# Autodesk Inventor assembly: Montagem1
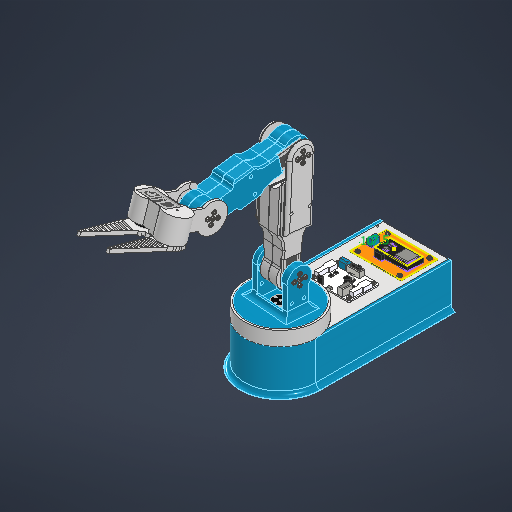
[picture p0: Inventor's stored thumbnail of the model, 512x512]
Saved by Autodesk Inventor 2027.1 (Build 311270010, 270A)
## iProperties
Created: 2026-11-04
Part Number: Montagem1
Document SubType Name: Assembly
Designer: Evellyn
Author: Evellyn
## Documents named in this file (21)
- C:\Users\Evellyn\Desktop\New-Robotic-Arm\mecanica\partes_ipt\Montagem1.iam
- C:\Users\Evellyn\Desktop\New-Robotic-Arm\mecanica\partes_ipt\modificacao_manipulador_base.ipt
- C:\Users\Evellyn\Desktop\New-Robotic-Arm\mecanica\partes_ipt\fonte.ipt
- C:\Users\Evellyn\Desktop\New-Robotic-Arm\mecanica\partes_ipt\modificacao_tampa_base.ipt
- C:\Users\Evellyn\Desktop\New-Robotic-Arm\mecanica\partes_ipt\PCB.ipt
- C:\Users\Evellyn\Desktop\New-Robotic-Arm\mecanica\partes_ipt\SERIAL_BUS_SERVO_CONTROLLER.ipt
- C:\Users\Evellyn\Desktop\New-Robotic-Arm\mecanica\partes_ipt\STEP_DOWN_LM2596.ipt
- C:\Users\Evellyn\Documents\Inventor\Content Center Files\R2027\pt-BR\NF EN ISO 7045 - Z\EN ISO 7045 - M3 x 5 - 4.8 - Z(2).ipt
- C:\Users\Evellyn\Documents\Inventor\Content Center Files\R2027\pt-BR\NF EN ISO 7045 - Z\EN ISO 7045 - M3 x 4 - 4.8 - Z(2).ipt
- C:\Users\Evellyn\Desktop\New-Robotic-Arm\mecanica\partes_ipt\servo LX-15D 2.ipt
- C:\Users\Evellyn\Documents\Inventor\Content Center Files\R2027\pt-BR\NF EN ISO 7045 - Z\EN ISO 7045 - M3 x 8 - 4.8 - Z(2).ipt
- C:\Users\Evellyn\Downloads\BaseS1P1.V4 (1).ipt
- C:\Users\Evellyn\Downloads\BaseS2P1V4 (1).ipt
- C:\Users\Evellyn\Downloads\servo_horn_gear_lx-15d-1.snapshot.1\Servo_Horn_Gear_LX-15D v4\Servo_Horn_Gear_LX-15D v4.iam
- C:\Users\Evellyn\Downloads\Braço1.v1.EV.ipt
- C:\Users\Evellyn\Downloads\servo_horn_with_bearing_lx-15d-1.snapshot.1\Servo_Horn_LX-15D v2\Servo_Horn_LX-15D v2.iam
- C:\Users\Evellyn\Documents\Inventor\Content Center Files\R2027\pt-BR\NF EN ISO 7045 - Z\EN ISO 7045 - M3 x 10 - 4.8 - Z(2).ipt
- C:\Users\Evellyn\Downloads\Braço3.v1.EV2.ipt
- C:\Users\Evellyn\Downloads\Braço4.v1.EV.ipt
- C:\Users\Evellyn\Downloads\SuporteGarraP2.ipt
- C:\Users\Evellyn\Downloads\GarraBraçoP1.ipt
## Components (69 placed, 20 different names)
1. modificacao_manipulador_base:1 — Coincidente:1, Coincidente:2, Coincidente:3, Coincidente:4, Coincidente:5, Coincidente:7, Coincidente:8, Coincidente:9, Coincidente:39, Coincidente:41
2. fonte:1 — Coincidente:4, Coincidente:5
3. modificacao_tampa_base:1 — Coincidente:7, Coincidente:8, Coincidente:10, Coincidente:11, Coincidente:12, Coincidente:13, Coincidente:14, Coincidente:23, Coincidente:24, Coincidente:25, Coincidente:26, Coincidente:27, Coincidente:40
4. SERIAL_BUS_SERVO_CONTROLLER:1 — Coincidente:10, Coincidente:11, Coincidente:12, Coincidente:13, Coincidente:14, Coincidente:15, Coincidente:16, Coincidente:17, Coincidente:18, Coincidente:19, Coincidente:20, Coincidente:21, Coincidente:22
5. STEP_DOWN_LM2596:1 — Coincidente:9
6. NF EN ISO 7045 - Z M3 x 5 - 4.8 - Z:2 — Coincidente:15, Coincidente:16
7. NF EN ISO 7045 - Z M3 x 5 - 4.8 - Z:3 — Coincidente:17, Coincidente:18
8. NF EN ISO 7045 - Z M3 x 4 - 4.8 - Z:1 — Coincidente:19, Coincidente:20
9. NF EN ISO 7045 - Z M3 x 4 - 4.8 - Z:2 — Coincidente:21, Coincidente:22
10. NF EN ISO 7045 - Z M3 x 5 - 4.8 - Z:4 — Coincidente:34, Coincidente:35
11. NF EN ISO 7045 - Z M3 x 5 - 4.8 - Z:5 — Coincidente:32, Coincidente:33
12. NF EN ISO 7045 - Z M3 x 5 - 4.8 - Z:6 — Coincidente:28, Coincidente:29
13. NF EN ISO 7045 - Z M3 x 5 - 4.8 - Z:7 — Coincidente:30, Coincidente:31
14. PCB:1 — Coincidente:23, Coincidente:24, Coincidente:25, Coincidente:26, Coincidente:27, Coincidente:28, Coincidente:29, Coincidente:30, Coincidente:31, Coincidente:32, Coincidente:33, Coincidente:34, Coincidente:35
15. servo LX-15D 2:1 — Coincidente:36, Coincidente:37, Coincidente:38, Coincidente:48
16. BaseS1P1.V4 (1):1 — Coincidente:36, Coincidente:37, Coincidente:38, Coincidente:39, Coincidente:40, Coincidente:41, Coincidente:42, Coincidente:43, Coincidente:44, Coincidente:45, Coincidente:46, Coincidente:47, Coincidente:49
17. NF EN ISO 7045 - Z M3 x 8 - 4.8 - Z:1 — Coincidente:46, Coincidente:47
18. NF EN ISO 7045 - Z M3 x 8 - 4.8 - Z:2 — Coincidente:44, Coincidente:45
19. NF EN ISO 7045 - Z M3 x 8 - 4.8 - Z:3 — Coincidente:42, Coincidente:43
20. BaseS2P1V4 (1):1 — Coincidente:48, Coincidente:49, Coincidente:50, Coincidente:51, Coincidente:61, Coincidente:62, Coincidente:63, Coincidente:64, Coincidente:65, Coincidente:66, Coincidente:67, Coincidente:68, Coincidente:69, Coincidente:70, Coincidente:71, Coincidente:72, Coincidente:73, Coincidente:74, Coincidente:75, Coincidente:76, Coincidente:77, Coincidente:78, Coincidente:79, Coincidente:80, Coincidente:81, Coincidente:82, Coincidente:83, Coincidente:84, Coincidente:85, Coincidente:86
21. Servo_Horn_Gear_LX-15D v4:1 [sub-assembly] — Coincidente:50, Coincidente:51
22. Braço1.v1.EV:1 — Coincidente:52, Coincidente:53, Coincidente:54, Coincidente:98, Coincidente:99, Coincidente:100, Coincidente:101, Coincidente:102, Coincidente:103, Coincidente:104, Coincidente:105, Coincidente:106, Coincidente:107, Coincidente:108, Coincidente:109, Coincidente:110, Coincidente:111, Coincidente:112, Coincidente:113
23. servo LX-15D 2:3 — Coincidente:52, Coincidente:53, Coincidente:54, Coincidente:55, Coincidente:56, Coincidente:57, Coincidente:58, Coincidente:59, Coincidente:60
24. Braço1.v1.EV:3 — Coincidente:55, Coincidente:56, Coincidente:57, Coincidente:97, Coincidente:114, Coincidente:115, Coincidente:116, Coincidente:117, Coincidente:118, Coincidente:119, Coincidente:120, Coincidente:121, Coincidente:122, Coincidente:123
25. Servo_Horn_Gear_LX-15D v4:3 [sub-assembly] — Coincidente:58, Coincidente:59, Coincidente:62, Coincidente:63, Coincidente:64, Coincidente:65, Coincidente:66
26. Servo_Horn_LX-15D v2:1 [sub-assembly] — Coincidente:60, Coincidente:61
27. NF EN ISO 7045 - Z M3 x 10 - 4.8 - Z:1 — Coincidente:67, Coincidente:69
28. NF EN ISO 7045 - Z M3 x 10 - 4.8 - Z:2 — Coincidente:75, Coincidente:76
29. NF EN ISO 7045 - Z M3 x 10 - 4.8 - Z:3 — Coincidente:72, Coincidente:74
30. NF EN ISO 7045 - Z M3 x 10 - 4.8 - Z:4 — Coincidente:68, Coincidente:70
31. NF EN ISO 7045 - Z M3 x 10 - 4.8 - Z:5 — Coincidente:71, Coincidente:73
32. NF EN ISO 7045 - Z M3 x 10 - 4.8 - Z:6 — Coincidente:77, Coincidente:82
33. NF EN ISO 7045 - Z M3 x 10 - 4.8 - Z:7 — Coincidente:79, Coincidente:80
34. NF EN ISO 7045 - Z M3 x 10 - 4.8 - Z:8 — Coincidente:78, Coincidente:81
35. NF EN ISO 7045 - Z M3 x 10 - 4.8 - Z:9 — Coincidente:84, Coincidente:86
36. NF EN ISO 7045 - Z M3 x 10 - 4.8 - Z:10 — Coincidente:83, Coincidente:85
37. Braço3.v1.EV2:1 — Coincidente:87, Coincidente:88, Coincidente:89
38. servo LX-15D 2:4 — Coincidente:87, Coincidente:88, Coincidente:89, Coincidente:90, Coincidente:91, Coincidente:92, Coincidente:93, Coincidente:94, Coincidente:95, Coincidente:96, Coincidente:98
39. Braço4.v1.EV:2 — Coincidente:90, Coincidente:91, Coincidente:92, Coincidente:124, Coincidente:125, Coincidente:126
40. Servo_Horn_Gear_LX-15D v4:4 [sub-assembly] — Coincidente:93, Coincidente:94, Coincidente:99, Coincidente:100, Coincidente:101, Coincidente:102, Coincidente:103
41. Servo_Horn_LX-15D v2:2 [sub-assembly] — Coincidente:95, Coincidente:96, Coincidente:97
42. NF EN ISO 7045 - Z M3 x 10 - 4.8 - Z:11 — Coincidente:105, Coincidente:108
43. NF EN ISO 7045 - Z M3 x 10 - 4.8 - Z:12 — Coincidente:110, Coincidente:112
44. NF EN ISO 7045 - Z M3 x 10 - 4.8 - Z:13 — Coincidente:104, Coincidente:109
45. NF EN ISO 7045 - Z M3 x 10 - 4.8 - Z:14 — Coincidente:106, Coincidente:107
46. NF EN ISO 7045 - Z M3 x 10 - 4.8 - Z:15 — Coincidente:111, Coincidente:113
47. NF EN ISO 7045 - Z M3 x 10 - 4.8 - Z:16 — Coincidente:114, Coincidente:120
48. NF EN ISO 7045 - Z M3 x 10 - 4.8 - Z:17 — Coincidente:116, Coincidente:119
49. NF EN ISO 7045 - Z M3 x 10 - 4.8 - Z:18 — Coincidente:122, Coincidente:123
50. NF EN ISO 7045 - Z M3 x 10 - 4.8 - Z:19 — Coincidente:117, Coincidente:118
51. NF EN ISO 7045 - Z M3 x 10 - 4.8 - Z:20 — Coincidente:115, Coincidente:121
52. servo LX-15D 2:5 — Coincidente:124, Coincidente:125, Coincidente:126, Coincidente:127, Coincidente:128, Coincidente:129, Coincidente:130
53. SuporteGarraP2:3 — Coincidente:131, Coincidente:132, Coincidente:133, Coincidente:134, Coincidente:135, Coincidente:136, Coincidente:137, Coincidente:138, Coincidente:139, Coincidente:140, Coincidente:141, Coincidente:142, Coincidente:143, Coincidente:144, Coincidente:145, Coincidente:146, Coincidente:147, Coincidente:148, Coincidente:149, Coincidente:150, Coincidente:151, Coincidente:152, Coincidente:153, Coincidente:154, Coincidente:155, Coincidente:156, Coincidente:157, Coincidente:158, Coincidente:159, Coincidente:164, Coincidente:165
54. Servo_Horn_LX-15D v2:3 [sub-assembly] — Coincidente:127, Coincidente:128
55. Servo_Horn_Gear_LX-15D v4:6 [sub-assembly] — Coincidente:129, Coincidente:130, Coincidente:131, Coincidente:132, Coincidente:133, Coincidente:134, Coincidente:135, Coincidente:136
56. NF EN ISO 7045 - Z M3 x 10 - 4.8 - Z:21 — Coincidente:137, Coincidente:142
57. NF EN ISO 7045 - Z M3 x 10 - 4.8 - Z:22 — Coincidente:144, Coincidente:146
58. NF EN ISO 7045 - Z M3 x 10 - 4.8 - Z:23 — Coincidente:139, Coincidente:141
59. NF EN ISO 7045 - Z M3 x 10 - 4.8 - Z:24 — Coincidente:143, Coincidente:145
60. NF EN ISO 7045 - Z M3 x 10 - 4.8 - Z:25 — Coincidente:138, Coincidente:140
61. NF EN ISO 7045 - Z M3 x 10 - 4.8 - Z:26 — Coincidente:152, Coincidente:156
62. NF EN ISO 7045 - Z M3 x 10 - 4.8 - Z:27 — Coincidente:148, Coincidente:149
63. NF EN ISO 7045 - Z M3 x 10 - 4.8 - Z:28 — Coincidente:151, Coincidente:155
64. NF EN ISO 7045 - Z M3 x 10 - 4.8 - Z:29 — Coincidente:147, Coincidente:150
65. NF EN ISO 7045 - Z M3 x 10 - 4.8 - Z:30 — Coincidente:153, Coincidente:154
66. servo LX-15D 2:6 — Coincidente:157, Coincidente:158, Coincidente:159, Coincidente:160, Coincidente:161
67. Servo_Horn_Gear_LX-15D v4:7 [sub-assembly] — Coincidente:160, Coincidente:161, Coincidente:162, Coincidente:163
68. GarraBraçoP1:1 — Coincidente:162, Coincidente:163
69. GarraBraçoP1:4 — Coincidente:164, Coincidente:165
## Relationships (164: Mate 164)
- Coincidente:1 [Mate]: modificacao_manipulador_base:1
- Coincidente:2 [Mate]: modificacao_manipulador_base:1
- Coincidente:3 [Mate]: modificacao_manipulador_base:1
- Coincidente:4 [Mate]: modificacao_manipulador_base:1 ↔ fonte:1
- Coincidente:5 [Mate]: modificacao_manipulador_base:1 ↔ fonte:1
- Coincidente:7 [Mate]: modificacao_manipulador_base:1 ↔ modificacao_tampa_base:1
- Coincidente:8 [Mate]: modificacao_manipulador_base:1 ↔ modificacao_tampa_base:1
- Coincidente:9 [Mate]: modificacao_manipulador_base:1 ↔ STEP_DOWN_LM2596:1
- Coincidente:10 [Mate]: modificacao_tampa_base:1 ↔ SERIAL_BUS_SERVO_CONTROLLER:1
- Coincidente:11 [Mate]: modificacao_tampa_base:1 ↔ SERIAL_BUS_SERVO_CONTROLLER:1
- Coincidente:12 [Mate]: modificacao_tampa_base:1 ↔ SERIAL_BUS_SERVO_CONTROLLER:1
- Coincidente:13 [Mate]: modificacao_tampa_base:1 ↔ SERIAL_BUS_SERVO_CONTROLLER:1
- Coincidente:14 [Mate]: modificacao_tampa_base:1 ↔ SERIAL_BUS_SERVO_CONTROLLER:1
- Coincidente:15 [Mate]: SERIAL_BUS_SERVO_CONTROLLER:1 ↔ NF EN ISO 7045 - Z M3 x 5 - 4.8 - Z:2
- Coincidente:16 [Mate]: SERIAL_BUS_SERVO_CONTROLLER:1 ↔ NF EN ISO 7045 - Z M3 x 5 - 4.8 - Z:2
- Coincidente:17 [Mate]: SERIAL_BUS_SERVO_CONTROLLER:1 ↔ NF EN ISO 7045 - Z M3 x 5 - 4.8 - Z:3
- Coincidente:18 [Mate]: SERIAL_BUS_SERVO_CONTROLLER:1 ↔ NF EN ISO 7045 - Z M3 x 5 - 4.8 - Z:3
- Coincidente:19 [Mate]: SERIAL_BUS_SERVO_CONTROLLER:1 ↔ NF EN ISO 7045 - Z M3 x 4 - 4.8 - Z:1
- Coincidente:20 [Mate]: SERIAL_BUS_SERVO_CONTROLLER:1 ↔ NF EN ISO 7045 - Z M3 x 4 - 4.8 - Z:1
- Coincidente:21 [Mate]: SERIAL_BUS_SERVO_CONTROLLER:1 ↔ NF EN ISO 7045 - Z M3 x 4 - 4.8 - Z:2
- Coincidente:22 [Mate]: SERIAL_BUS_SERVO_CONTROLLER:1 ↔ NF EN ISO 7045 - Z M3 x 4 - 4.8 - Z:2
- Coincidente:23 [Mate]: modificacao_tampa_base:1 ↔ PCB:1
- Coincidente:24 [Mate]: modificacao_tampa_base:1 ↔ PCB:1
- Coincidente:25 [Mate]: modificacao_tampa_base:1 ↔ PCB:1
- Coincidente:26 [Mate]: modificacao_tampa_base:1 ↔ PCB:1
- Coincidente:27 [Mate]: modificacao_tampa_base:1 ↔ PCB:1
- Coincidente:28 [Mate]: NF EN ISO 7045 - Z M3 x 5 - 4.8 - Z:6 ↔ PCB:1
- Coincidente:29 [Mate]: NF EN ISO 7045 - Z M3 x 5 - 4.8 - Z:6 ↔ PCB:1
- Coincidente:30 [Mate]: NF EN ISO 7045 - Z M3 x 5 - 4.8 - Z:7 ↔ PCB:1
- Coincidente:31 [Mate]: NF EN ISO 7045 - Z M3 x 5 - 4.8 - Z:7 ↔ PCB:1
- Coincidente:32 [Mate]: NF EN ISO 7045 - Z M3 x 5 - 4.8 - Z:5 ↔ PCB:1
- Coincidente:33 [Mate]: NF EN ISO 7045 - Z M3 x 5 - 4.8 - Z:5 ↔ PCB:1
- Coincidente:34 [Mate]: NF EN ISO 7045 - Z M3 x 5 - 4.8 - Z:4 ↔ PCB:1
- Coincidente:35 [Mate]: NF EN ISO 7045 - Z M3 x 5 - 4.8 - Z:4 ↔ PCB:1
- Coincidente:36 [Mate]: servo LX-15D 2:1 ↔ BaseS1P1.V4 (1):1
- Coincidente:37 [Mate]: servo LX-15D 2:1 ↔ BaseS1P1.V4 (1):1
- Coincidente:38 [Mate]: servo LX-15D 2:1 ↔ BaseS1P1.V4 (1):1
- Coincidente:39 [Mate]: modificacao_manipulador_base:1 ↔ BaseS1P1.V4 (1):1
- Coincidente:40 [Mate]: modificacao_tampa_base:1 ↔ BaseS1P1.V4 (1):1
- Coincidente:41 [Mate]: modificacao_manipulador_base:1 ↔ BaseS1P1.V4 (1):1
- Coincidente:42 [Mate]: BaseS1P1.V4 (1):1 ↔ NF EN ISO 7045 - Z M3 x 8 - 4.8 - Z:3
- Coincidente:43 [Mate]: BaseS1P1.V4 (1):1 ↔ NF EN ISO 7045 - Z M3 x 8 - 4.8 - Z:3
- Coincidente:44 [Mate]: BaseS1P1.V4 (1):1 ↔ NF EN ISO 7045 - Z M3 x 8 - 4.8 - Z:2
- Coincidente:45 [Mate]: BaseS1P1.V4 (1):1 ↔ NF EN ISO 7045 - Z M3 x 8 - 4.8 - Z:2
- Coincidente:46 [Mate]: BaseS1P1.V4 (1):1 ↔ NF EN ISO 7045 - Z M3 x 8 - 4.8 - Z:1
- Coincidente:47 [Mate]: BaseS1P1.V4 (1):1 ↔ NF EN ISO 7045 - Z M3 x 8 - 4.8 - Z:1
- Coincidente:48 [Mate]: servo LX-15D 2:1 ↔ BaseS2P1V4 (1):1
- Coincidente:49 [Mate]: BaseS1P1.V4 (1):1 ↔ BaseS2P1V4 (1):1
- Coincidente:50 [Mate]: BaseS2P1V4 (1):1 ↔ Servo_Horn_Gear_LX-15D v4:1
- Coincidente:51 [Mate]: BaseS2P1V4 (1):1 ↔ Servo_Horn_Gear_LX-15D v4:1
- Coincidente:52 [Mate]: Braço1.v1.EV:1 ↔ servo LX-15D 2:3
- Coincidente:53 [Mate]: Braço1.v1.EV:1 ↔ servo LX-15D 2:3
- Coincidente:54 [Mate]: Braço1.v1.EV:1 ↔ servo LX-15D 2:3
- Coincidente:55 [Mate]: servo LX-15D 2:3 ↔ Braço1.v1.EV:3
- Coincidente:56 [Mate]: servo LX-15D 2:3 ↔ Braço1.v1.EV:3
- Coincidente:57 [Mate]: servo LX-15D 2:3 ↔ Braço1.v1.EV:3
- Coincidente:58 [Mate]: servo LX-15D 2:3 ↔ Servo_Horn_Gear_LX-15D v4:3
- Coincidente:59 [Mate]: servo LX-15D 2:3 ↔ Servo_Horn_Gear_LX-15D v4:3
- Coincidente:60 [Mate]: servo LX-15D 2:3 ↔ Servo_Horn_LX-15D v2:1
- Coincidente:61 [Mate]: BaseS2P1V4 (1):1 ↔ Servo_Horn_LX-15D v2:1
- Coincidente:62 [Mate]: BaseS2P1V4 (1):1 ↔ Servo_Horn_Gear_LX-15D v4:3
- Coincidente:63 [Mate]: BaseS2P1V4 (1):1 ↔ Servo_Horn_Gear_LX-15D v4:3
- Coincidente:64 [Mate]: BaseS2P1V4 (1):1 ↔ Servo_Horn_Gear_LX-15D v4:3
- Coincidente:65 [Mate]: BaseS2P1V4 (1):1 ↔ Servo_Horn_Gear_LX-15D v4:3
- Coincidente:66 [Mate]: BaseS2P1V4 (1):1 ↔ Servo_Horn_Gear_LX-15D v4:3
- Coincidente:67 [Mate]: BaseS2P1V4 (1):1 ↔ NF EN ISO 7045 - Z M3 x 10 - 4.8 - Z:1
- Coincidente:68 [Mate]: BaseS2P1V4 (1):1 ↔ NF EN ISO 7045 - Z M3 x 10 - 4.8 - Z:4
- Coincidente:69 [Mate]: BaseS2P1V4 (1):1 ↔ NF EN ISO 7045 - Z M3 x 10 - 4.8 - Z:1
- Coincidente:70 [Mate]: BaseS2P1V4 (1):1 ↔ NF EN ISO 7045 - Z M3 x 10 - 4.8 - Z:4
- Coincidente:71 [Mate]: BaseS2P1V4 (1):1 ↔ NF EN ISO 7045 - Z M3 x 10 - 4.8 - Z:5
- Coincidente:72 [Mate]: BaseS2P1V4 (1):1 ↔ NF EN ISO 7045 - Z M3 x 10 - 4.8 - Z:3
- Coincidente:73 [Mate]: BaseS2P1V4 (1):1 ↔ NF EN ISO 7045 - Z M3 x 10 - 4.8 - Z:5
- Coincidente:74 [Mate]: BaseS2P1V4 (1):1 ↔ NF EN ISO 7045 - Z M3 x 10 - 4.8 - Z:3
- Coincidente:75 [Mate]: BaseS2P1V4 (1):1 ↔ NF EN ISO 7045 - Z M3 x 10 - 4.8 - Z:2
- Coincidente:76 [Mate]: BaseS2P1V4 (1):1 ↔ NF EN ISO 7045 - Z M3 x 10 - 4.8 - Z:2
- Coincidente:77 [Mate]: BaseS2P1V4 (1):1 ↔ NF EN ISO 7045 - Z M3 x 10 - 4.8 - Z:6
- Coincidente:78 [Mate]: BaseS2P1V4 (1):1 ↔ NF EN ISO 7045 - Z M3 x 10 - 4.8 - Z:8
- Coincidente:79 [Mate]: BaseS2P1V4 (1):1 ↔ NF EN ISO 7045 - Z M3 x 10 - 4.8 - Z:7
- Coincidente:80 [Mate]: BaseS2P1V4 (1):1 ↔ NF EN ISO 7045 - Z M3 x 10 - 4.8 - Z:7
- Coincidente:81 [Mate]: BaseS2P1V4 (1):1 ↔ NF EN ISO 7045 - Z M3 x 10 - 4.8 - Z:8
- Coincidente:82 [Mate]: BaseS2P1V4 (1):1 ↔ NF EN ISO 7045 - Z M3 x 10 - 4.8 - Z:6
- Coincidente:83 [Mate]: BaseS2P1V4 (1):1 ↔ NF EN ISO 7045 - Z M3 x 10 - 4.8 - Z:10
- Coincidente:84 [Mate]: BaseS2P1V4 (1):1 ↔ NF EN ISO 7045 - Z M3 x 10 - 4.8 - Z:9
- Coincidente:85 [Mate]: BaseS2P1V4 (1):1 ↔ NF EN ISO 7045 - Z M3 x 10 - 4.8 - Z:10
- Coincidente:86 [Mate]: BaseS2P1V4 (1):1 ↔ NF EN ISO 7045 - Z M3 x 10 - 4.8 - Z:9
- Coincidente:87 [Mate]: Braço3.v1.EV2:1 ↔ servo LX-15D 2:4
- Coincidente:88 [Mate]: Braço3.v1.EV2:1 ↔ servo LX-15D 2:4
- Coincidente:89 [Mate]: Braço3.v1.EV2:1 ↔ servo LX-15D 2:4
- Coincidente:90 [Mate]: servo LX-15D 2:4 ↔ Braço4.v1.EV:2
- Coincidente:91 [Mate]: servo LX-15D 2:4 ↔ Braço4.v1.EV:2
- Coincidente:92 [Mate]: servo LX-15D 2:4 ↔ Braço4.v1.EV:2
- Coincidente:93 [Mate]: servo LX-15D 2:4 ↔ Servo_Horn_Gear_LX-15D v4:4
- Coincidente:94 [Mate]: servo LX-15D 2:4 ↔ Servo_Horn_Gear_LX-15D v4:4
- Coincidente:95 [Mate]: servo LX-15D 2:4 ↔ Servo_Horn_LX-15D v2:2
- Coincidente:96 [Mate]: servo LX-15D 2:4 ↔ Servo_Horn_LX-15D v2:2
- Coincidente:97 [Mate]: Braço1.v1.EV:3 ↔ Servo_Horn_LX-15D v2:2
- Coincidente:98 [Mate]: Braço1.v1.EV:1 ↔ servo LX-15D 2:4
- Coincidente:99 [Mate]: Braço1.v1.EV:1 ↔ Servo_Horn_Gear_LX-15D v4:4
- Coincidente:100 [Mate]: Braço1.v1.EV:1 ↔ Servo_Horn_Gear_LX-15D v4:4
- Coincidente:101 [Mate]: Braço1.v1.EV:1 ↔ Servo_Horn_Gear_LX-15D v4:4
- Coincidente:102 [Mate]: Braço1.v1.EV:1 ↔ Servo_Horn_Gear_LX-15D v4:4
- Coincidente:103 [Mate]: Braço1.v1.EV:1 ↔ Servo_Horn_Gear_LX-15D v4:4
- Coincidente:104 [Mate]: Braço1.v1.EV:1 ↔ NF EN ISO 7045 - Z M3 x 10 - 4.8 - Z:13
- Coincidente:105 [Mate]: Braço1.v1.EV:1 ↔ NF EN ISO 7045 - Z M3 x 10 - 4.8 - Z:11
- Coincidente:106 [Mate]: Braço1.v1.EV:1 ↔ NF EN ISO 7045 - Z M3 x 10 - 4.8 - Z:14
- Coincidente:107 [Mate]: Braço1.v1.EV:1 ↔ NF EN ISO 7045 - Z M3 x 10 - 4.8 - Z:14
- Coincidente:108 [Mate]: Braço1.v1.EV:1 ↔ NF EN ISO 7045 - Z M3 x 10 - 4.8 - Z:11
- Coincidente:109 [Mate]: Braço1.v1.EV:1 ↔ NF EN ISO 7045 - Z M3 x 10 - 4.8 - Z:13
- Coincidente:110 [Mate]: Braço1.v1.EV:1 ↔ NF EN ISO 7045 - Z M3 x 10 - 4.8 - Z:12
- Coincidente:111 [Mate]: Braço1.v1.EV:1 ↔ NF EN ISO 7045 - Z M3 x 10 - 4.8 - Z:15
- Coincidente:112 [Mate]: Braço1.v1.EV:1 ↔ NF EN ISO 7045 - Z M3 x 10 - 4.8 - Z:12
- Coincidente:113 [Mate]: Braço1.v1.EV:1 ↔ NF EN ISO 7045 - Z M3 x 10 - 4.8 - Z:15
- Coincidente:114 [Mate]: Braço1.v1.EV:3 ↔ NF EN ISO 7045 - Z M3 x 10 - 4.8 - Z:16
- Coincidente:115 [Mate]: Braço1.v1.EV:3 ↔ NF EN ISO 7045 - Z M3 x 10 - 4.8 - Z:20
- Coincidente:116 [Mate]: Braço1.v1.EV:3 ↔ NF EN ISO 7045 - Z M3 x 10 - 4.8 - Z:17
- Coincidente:117 [Mate]: Braço1.v1.EV:3 ↔ NF EN ISO 7045 - Z M3 x 10 - 4.8 - Z:19
- Coincidente:118 [Mate]: Braço1.v1.EV:3 ↔ NF EN ISO 7045 - Z M3 x 10 - 4.8 - Z:19
- Coincidente:119 [Mate]: Braço1.v1.EV:3 ↔ NF EN ISO 7045 - Z M3 x 10 - 4.8 - Z:17
- Coincidente:120 [Mate]: Braço1.v1.EV:3 ↔ NF EN ISO 7045 - Z M3 x 10 - 4.8 - Z:16
- Coincidente:121 [Mate]: Braço1.v1.EV:3 ↔ NF EN ISO 7045 - Z M3 x 10 - 4.8 - Z:20
- Coincidente:122 [Mate]: Braço1.v1.EV:3 ↔ NF EN ISO 7045 - Z M3 x 10 - 4.8 - Z:18
- Coincidente:123 [Mate]: Braço1.v1.EV:3 ↔ NF EN ISO 7045 - Z M3 x 10 - 4.8 - Z:18
- Coincidente:124 [Mate]: Braço4.v1.EV:2 ↔ servo LX-15D 2:5
- Coincidente:125 [Mate]: Braço4.v1.EV:2 ↔ servo LX-15D 2:5
- Coincidente:126 [Mate]: Braço4.v1.EV:2 ↔ servo LX-15D 2:5
- Coincidente:127 [Mate]: servo LX-15D 2:5 ↔ Servo_Horn_LX-15D v2:3
- Coincidente:128 [Mate]: servo LX-15D 2:5 ↔ Servo_Horn_LX-15D v2:3
- Coincidente:129 [Mate]: servo LX-15D 2:5 ↔ Servo_Horn_Gear_LX-15D v4:6
- Coincidente:130 [Mate]: servo LX-15D 2:5 ↔ Servo_Horn_Gear_LX-15D v4:6
- Coincidente:131 [Mate]: SuporteGarraP2:3 ↔ Servo_Horn_Gear_LX-15D v4:6
- Coincidente:132 [Mate]: SuporteGarraP2:3 ↔ Servo_Horn_Gear_LX-15D v4:6
- Coincidente:133 [Mate]: SuporteGarraP2:3 ↔ Servo_Horn_Gear_LX-15D v4:6
- Coincidente:134 [Mate]: SuporteGarraP2:3 ↔ Servo_Horn_Gear_LX-15D v4:6
- Coincidente:135 [Mate]: SuporteGarraP2:3 ↔ Servo_Horn_Gear_LX-15D v4:6
- Coincidente:136 [Mate]: SuporteGarraP2:3 ↔ Servo_Horn_Gear_LX-15D v4:6
- Coincidente:137 [Mate]: SuporteGarraP2:3 ↔ NF EN ISO 7045 - Z M3 x 10 - 4.8 - Z:21
- Coincidente:138 [Mate]: SuporteGarraP2:3 ↔ NF EN ISO 7045 - Z M3 x 10 - 4.8 - Z:25
- Coincidente:139 [Mate]: SuporteGarraP2:3 ↔ NF EN ISO 7045 - Z M3 x 10 - 4.8 - Z:23
- Coincidente:140 [Mate]: SuporteGarraP2:3 ↔ NF EN ISO 7045 - Z M3 x 10 - 4.8 - Z:25
- Coincidente:141 [Mate]: SuporteGarraP2:3 ↔ NF EN ISO 7045 - Z M3 x 10 - 4.8 - Z:23
- Coincidente:142 [Mate]: SuporteGarraP2:3 ↔ NF EN ISO 7045 - Z M3 x 10 - 4.8 - Z:21
- Coincidente:143 [Mate]: SuporteGarraP2:3 ↔ NF EN ISO 7045 - Z M3 x 10 - 4.8 - Z:24
- Coincidente:144 [Mate]: SuporteGarraP2:3 ↔ NF EN ISO 7045 - Z M3 x 10 - 4.8 - Z:22
- Coincidente:145 [Mate]: SuporteGarraP2:3 ↔ NF EN ISO 7045 - Z M3 x 10 - 4.8 - Z:24
- Coincidente:146 [Mate]: SuporteGarraP2:3 ↔ NF EN ISO 7045 - Z M3 x 10 - 4.8 - Z:22
- Coincidente:147 [Mate]: SuporteGarraP2:3 ↔ NF EN ISO 7045 - Z M3 x 10 - 4.8 - Z:29
- Coincidente:148 [Mate]: SuporteGarraP2:3 ↔ NF EN ISO 7045 - Z M3 x 10 - 4.8 - Z:27
- Coincidente:149 [Mate]: SuporteGarraP2:3 ↔ NF EN ISO 7045 - Z M3 x 10 - 4.8 - Z:27
- Coincidente:150 [Mate]: SuporteGarraP2:3 ↔ NF EN ISO 7045 - Z M3 x 10 - 4.8 - Z:29
- Coincidente:151 [Mate]: SuporteGarraP2:3 ↔ NF EN ISO 7045 - Z M3 x 10 - 4.8 - Z:28
- Coincidente:152 [Mate]: SuporteGarraP2:3 ↔ NF EN ISO 7045 - Z M3 x 10 - 4.8 - Z:26
- Coincidente:153 [Mate]: SuporteGarraP2:3 ↔ NF EN ISO 7045 - Z M3 x 10 - 4.8 - Z:30
- Coincidente:154 [Mate]: SuporteGarraP2:3 ↔ NF EN ISO 7045 - Z M3 x 10 - 4.8 - Z:30
- Coincidente:155 [Mate]: SuporteGarraP2:3 ↔ NF EN ISO 7045 - Z M3 x 10 - 4.8 - Z:28
- Coincidente:156 [Mate]: SuporteGarraP2:3 ↔ NF EN ISO 7045 - Z M3 x 10 - 4.8 - Z:26
- Coincidente:157 [Mate]: SuporteGarraP2:3 ↔ servo LX-15D 2:6
- Coincidente:158 [Mate]: SuporteGarraP2:3 ↔ servo LX-15D 2:6
- Coincidente:159 [Mate]: SuporteGarraP2:3 ↔ servo LX-15D 2:6
- Coincidente:160 [Mate]: servo LX-15D 2:6 ↔ Servo_Horn_Gear_LX-15D v4:7
- Coincidente:161 [Mate]: servo LX-15D 2:6 ↔ Servo_Horn_Gear_LX-15D v4:7
- Coincidente:162 [Mate]: Servo_Horn_Gear_LX-15D v4:7 ↔ GarraBraçoP1:1
- Coincidente:163 [Mate]: Servo_Horn_Gear_LX-15D v4:7 ↔ GarraBraçoP1:1
- Coincidente:164 [Mate]: SuporteGarraP2:3 ↔ GarraBraçoP1:4
- Coincidente:165 [Mate]: SuporteGarraP2:3 ↔ GarraBraçoP1:4
